# Autodesk Inventor assembly: polia_montada
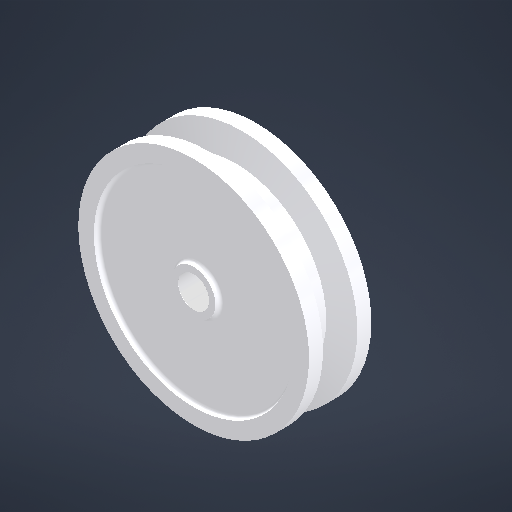
[picture p0: Inventor's stored thumbnail of the model, 512x512]
Saved by Autodesk Inventor 2026 (Build 300175000, 175)
## iProperties
Created: 2025-04-24
Part Number: polia_montada
Document SubType Name: Assembly
Designer: dawac
Author: dawac
## Documents named in this file (3)
- C:\Users\dawac\OneDrive\Área de Trabalho\poli2025.1\pi7\mecanismo\polia\polia_montada.iam
- C:\Users\dawac\OneDrive\Área de Trabalho\poli2025.1\pi7\mecanismo\polia\polia.ipt
- C:\Users\dawac\OneDrive\Área de Trabalho\poli2025.1\pi7\mecanismo\polia\eixo_polia.ipt
## Components (2 placed, 2 different names)
1. polia:1 — Rotational:1
2. eixo_polia:1 — Rotational:1
## Relationships (1: RevoluteJoint 1)
- Rotational:1 [RevoluteJoint]: polia:1 ↔ eixo_polia:1
